# Autodesk Inventor assembly: ensamblaje soldado
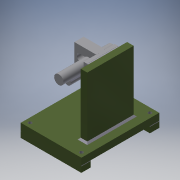
[picture p0: Inventor's stored thumbnail of the model, 180x180]
Saved by Autodesk Inventor 2017 (Build 210142000, 142)
## iProperties
Part Number: ensamblaje soldado
Material: Genérico
Document SubType Name: Weldment
Designer: HP Pav
Weld Material: Welded Aluminum-6061
Author: HP Pav
## Documents named in this file (7)
- C:\Users\HP Pav\Desktop\diseño 2º dfm\matriz corte\ensamblaje soldado.iam
- C:\Users\HP Pav\Desktop\diseño 2º dfm\matriz corte\base.ipt
- C:\Users\HP Pav\Desktop\diseño 2º dfm\matriz corte\largueros.ipt
- C:\Users\HP Pav\Desktop\diseño 2º dfm\matriz corte\soporte vertical.ipt
- C:\Users\HP Pav\Desktop\diseño 2º dfm\matriz corte\pieza soldada a vertical.ipt
- C:\Users\HP Pav\Desktop\diseño 2º dfm\matriz corte\nucleo eje.ipt
- C:\Users\HP Pav\Desktop\eje manivela.ipt
## Components (6 placed, 6 different names)
1. base:1 — Coincidencia:1, Nivelación:1, Nivelación:2, Coincidencia:2, Nivelación:3, Nivelación:4
2. largueros:1 — Coincidencia:1, Nivelación:1, Nivelación:2
3. soporte vertical:1 — Coincidencia:2, Nivelación:3, Nivelación:4, Coincidencia:3, Nivelación:5, Nivelación:6
4. pieza soldada a vertical:1 — Coincidencia:3, Nivelación:5, Coincidencia:5, Coincidencia:6, Nivelación:6, Nivelación:7
5. nucleo eje:1 — Coincidencia:5, Coincidencia:6, Coincidencia:8, Coincidencia:9, Nivelación:7
6. eje manivela:1 — Coincidencia:8, Coincidencia:9
## Relationships (14: Mate 7, Flush 7)
- Coincidencia:1 [Mate]: base:1 ↔ largueros:1
- Nivelación:1 [Flush]: base:1 ↔ largueros:1
- Nivelación:2 [Flush]: base:1 ↔ largueros:1
- Coincidencia:2 [Mate]: base:1 ↔ soporte vertical:1
- Nivelación:3 [Flush] (-30.8 mm): base:1 ↔ soporte vertical:1
- Nivelación:4 [Flush] (51.2 mm): base:1 ↔ soporte vertical:1
- Coincidencia:3 [Mate]: soporte vertical:1 ↔ pieza soldada a vertical:1
- Nivelación:5 [Flush] (25.3 mm): soporte vertical:1 ↔ pieza soldada a vertical:1
- Coincidencia:5 [Mate]: pieza soldada a vertical:1 ↔ nucleo eje:1
- Coincidencia:6 [Mate]: pieza soldada a vertical:1 ↔ nucleo eje:1
- Nivelación:6 [Flush]: soporte vertical:1 ↔ pieza soldada a vertical:1
- Coincidencia:8 [Mate]: nucleo eje:1 ↔ eje manivela:1
- Coincidencia:9 [Mate]: nucleo eje:1 ↔ eje manivela:1
- Nivelación:7 [Flush] (29.7 mm): pieza soldada a vertical:1 ↔ nucleo eje:1
